# Autodesk Inventor assembly: Assembly4
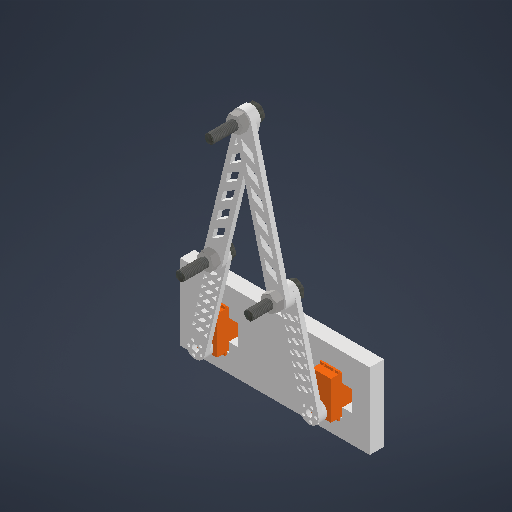
[picture p0: Inventor's stored thumbnail of the model, 512x512]
Saved by Autodesk Inventor 2026.1 (Build 301233020, 233B)
## iProperties
Created: 2026-04-08
Part Number: Assembly4
Document SubType Name: Assembly
Designer: kadir
Author: kadir
## Documents named in this file (8)
- C:\Users\kadir\Documents\FCC2\fcc 2\Assembly4.iam
- C:\Users\kadir\Documents\FCC2\fcc 2\ŞASE.ipt
- C:\Users\kadir\Documents\FCC2\fcc 2\MG995 motor.ipt
- C:\Users\kadir\Documents\FCC2\fcc 2\motor bloğu.ipt
- C:\Users\kadir\Documents\FCC2\fcc 2\link1.ipt
- C:\Users\kadir\Documents\FCC2\fcc 2\link2.ipt
- C:\Users\kadir\Documents\Inventor\Content Center Files\R2026\en-US\BS EN ISO 4016\BS EN ISO 4016 - M10x45.ipt
- C:\Users\kadir\Documents\Inventor\Content Center Files\R2026\en-US\AS 1112 (2)\AS 1112 - M10  Type 8.ipt
## Components (15 placed, 7 different names)
1. ŞASE:1 — Mate:1, Mate:2, Mate:3, Mate:4, Mate:5
2. MG995 motor:1 — Mate:1, Mate:2, Mate:3, Mate:6, Mate:7
3. MG995 motor:2 — Mate:4, Mate:5, Mate:8, Mate:9, Mate:14
4. motor bloğu:1 — Mate:6, Mate:7, Mate:10, Mate:11, Mate:12, Mate:13
5. motor bloğu:2 — Mate:8, Mate:9, Mate:15, Mate:16, Mate:17, Mate:18
6. link1:1 — Mate:10, Mate:11, Mate:12, Mate:13, Mate:19, Mate:20, Mate:27
7. link1:2 — Mate:14, Mate:15, Mate:16, Mate:17, Mate:18, Mate:21, Mate:22, Mate:25
8. link2:1 — Mate:19, Mate:20, Mate:23, Mate:26, Mate:29, Mate:33
9. link2:2 — Mate:21, Mate:22, Mate:23, Mate:24, Mate:28, Mate:31, Mate:35
10. BS EN ISO 4016 M10x45:1 — Mate:24, Mate:25, Mate:30
11. BS EN ISO 4016 M10x45:2 — Mate:28, Mate:29, Mate:34
12. BS EN ISO 4016 M10x45:3 — Mate:26, Mate:27, Mate:32
13. AS 1112 (2) - Metric M10  Type 8:1 — Mate:32, Mate:33
14. AS 1112 (2) - Metric M10  Type 8:2 — Mate:30, Mate:31
15. AS 1112 (2) - Metric M10  Type 8:3 — Mate:34, Mate:35
## Relationships (35: Mate 35)
- Mate:1: ŞASE:1 ↔ MG995 motor:1
- Mate:2: ŞASE:1 ↔ MG995 motor:1
- Mate:3: ŞASE:1 ↔ MG995 motor:1
- Mate:4: ŞASE:1 ↔ MG995 motor:2
- Mate:5: ŞASE:1 ↔ MG995 motor:2
- Mate:6: MG995 motor:1 ↔ motor bloğu:1
- Mate:7: MG995 motor:1 ↔ motor bloğu:1
- Mate:8: MG995 motor:2 ↔ motor bloğu:2
- Mate:9: MG995 motor:2 ↔ motor bloğu:2
- Mate:10: motor bloğu:1 ↔ link1:1
- Mate:11: motor bloğu:1 ↔ link1:1
- Mate:12: motor bloğu:1 ↔ link1:1
- Mate:13: motor bloğu:1 ↔ link1:1
- Mate:14: MG995 motor:2 ↔ link1:2
- Mate:15: motor bloğu:2 ↔ link1:2
- Mate:16: motor bloğu:2 ↔ link1:2
- Mate:17: motor bloğu:2 ↔ link1:2
- Mate:18: motor bloğu:2 ↔ link1:2
- Mate:19: link1:1 ↔ link2:1
- Mate:20: link1:1 ↔ link2:1
- Mate:21: link1:2 ↔ link2:2
- Mate:22: link1:2 ↔ link2:2
- Mate:23: link2:1 ↔ link2:2
- Mate:24: link2:2 ↔ BS EN ISO 4016 M10x45:1
- Mate:25: link1:2 ↔ BS EN ISO 4016 M10x45:1
- Mate:26: link2:1 ↔ BS EN ISO 4016 M10x45:3
- Mate:27: link1:1 ↔ BS EN ISO 4016 M10x45:3
- Mate:28: link2:2 ↔ BS EN ISO 4016 M10x45:2
- Mate:29: link2:1 ↔ BS EN ISO 4016 M10x45:2
- Mate:30: BS EN ISO 4016 M10x45:1 ↔ AS 1112 (2) - Metric M10  Type 8:2
- Mate:31: link2:2 ↔ AS 1112 (2) - Metric M10  Type 8:2
- Mate:32: BS EN ISO 4016 M10x45:3 ↔ AS 1112 (2) - Metric M10  Type 8:1
- Mate:33: link2:1 ↔ AS 1112 (2) - Metric M10  Type 8:1
- Mate:34: BS EN ISO 4016 M10x45:2 ↔ AS 1112 (2) - Metric M10  Type 8:3
- Mate:35: link2:2 ↔ AS 1112 (2) - Metric M10  Type 8:3
